# Autodesk Inventor assembly: 荷叶模块
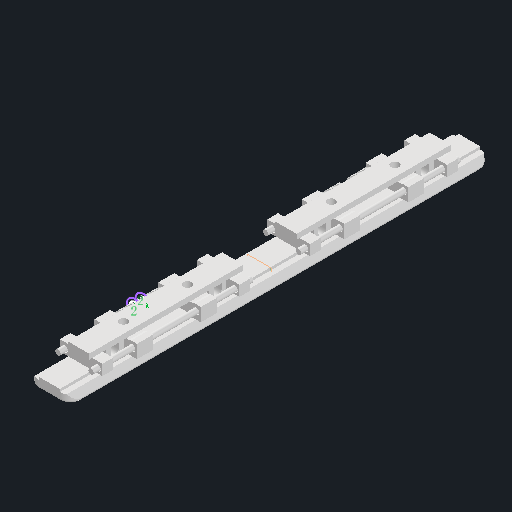
[picture p0: Inventor's stored thumbnail of the model, 512x512]
Saved by Autodesk Inventor 2025 (Build 290162000, 162)
## iProperties
Created: 2025-08-27
Part Number: 荷叶模块
Document SubType Name: Assembly
Designer: HZD
Author: HZD
## Documents named in this file (4)
- D:\2 B Mechanical design\有光\铰链\荷叶模块.iam
- D:\2 B Mechanical design\有光\铰链\扭力装配体.iam
- D:\2 B Mechanical design\有光\铰链\扭力模块板.ipt
- D:\2 B Mechanical design\有光\铰链\扭力模块板1.ipt
## Components (5 placed, 3 different names)
1. 扭力装配体:1 [sub-assembly] — 配合:16, 配合:17, 配合:18
2. 扭力模块板1:1 — 配合:16, 配合:17, 配合:18, 对称:1
3. 扭力装配体:2 [sub-assembly]
4. 扭力模块板1:2 — 对称:1
5. 扭力模块板:2
## Relationships (7: Mate 6, Symmetry 1)
- 配合:16 [Mate]: 扭力装配体:1 ↔ 扭力模块板1:1
- 配合:17 [Mate]: 扭力装配体:1 ↔ 扭力模块板1:1
- 配合:18 [Mate]: 扭力装配体:1 ↔ 扭力模块板1:1
- [Mate]: 扭力装配体:2 ↔ 扭力模块板1:2
- [Mate]: 扭力装配体:2 ↔ 扭力模块板1:2
- [Mate]: 扭力装配体:2 ↔ 扭力模块板1:2
- 对称:1 [Symmetry]: 扭力模块板1:1 ↔ 扭力模块板1:2
## Named parameters: d54_d48 = 0 mm, d55_d51 = 0 mm, d56_d52 = 0 mm
